# Autodesk Inventor assembly: BuckConverter_10A_Assembly
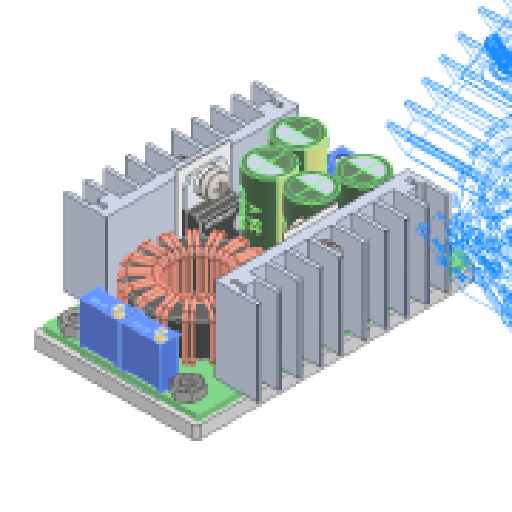
[picture p0: Inventor's stored thumbnail of the model, 512x512]
Saved by Autodesk Inventor 2025 (Build 290162000, 162)
## iProperties
Created: 2024-11-14
Part Number: BuckConverter_10A_Assembly
Document SubType Name: Assembly
Designer: OSB
Mass: 55.5 g
Surface Area: 335.586 cm^2
Volume: 25.8224 cm^3
Sending System: Autodesk Inventor 2021
Preprocessor: unknown
Minimum Resolution: 0.01
Sent Units: Millimeter
Translation Standard: IGES 5.3
Model Creation Time: 2020-07-07
Title: S500 Frame
Author: OSB
## Documents named in this file (4)
- C:\Users\OSB\Desktop\SB\1.Projects\캡스톤 디자인(2)_Paper\Modeling\Implementation_Design\Ver_004_mass_update\BuckConverter_10A_Assembly.iam
- C:\Users\OSB\Desktop\SB\1.Projects\캡스톤 디자인(2)_Paper\Modeling\Implementation_Design\Ver_004_mass_update\BuckConverter_10A_Module.ipt
- C:\Users\OSB\Desktop\SB\1.Projects\캡스톤 디자인(2)_Paper\Modeling\Implementation_Design\Ver_004_mass_update\BuckConverter_10A_Spacer.ipt
- C:\Users\OSB\Documents\Inventor\Content Center Files\R2025\ko-KR\KS B 1012  S2 F\KS B 1012 - M 3(1).ipt
## Components (6 placed, 3 different names)
1. BuckConverter_10A_Module:1 — 회전:1, 메이트:1, 삽입:1, 삽입:2, 삽입:3, 삽입:4
2. BuckConverter_10A_Spacer:1 — 회전:1, 메이트:1
3. KS B 1012 스타일 2 다듬질 - 미터 M 3:1 — 삽입:1
4. KS B 1012 스타일 2 다듬질 - 미터 M 3:2 — 삽입:2
5. KS B 1012 스타일 2 다듬질 - 미터 M 3:3 — 삽입:3
6. KS B 1012 스타일 2 다듬질 - 미터 M 3:4 — 삽입:4
## Relationships (6: Insert 4, RevoluteJoint 1, Mate 1)
- 회전:1 [RevoluteJoint]: BuckConverter_10A_Module:1 ↔ BuckConverter_10A_Spacer:1
- 메이트:1 [Mate]: BuckConverter_10A_Module:1 ↔ BuckConverter_10A_Spacer:1
- 삽입:1 [Insert]: BuckConverter_10A_Module:1 ↔ KS B 1012 스타일 2 다듬질 - 미터 M 3:1
- 삽입:2 [Insert]: BuckConverter_10A_Module:1 ↔ KS B 1012 스타일 2 다듬질 - 미터 M 3:2
- 삽입:3 [Insert]: BuckConverter_10A_Module:1 ↔ KS B 1012 스타일 2 다듬질 - 미터 M 3:3
- 삽입:4 [Insert]: BuckConverter_10A_Module:1 ↔ KS B 1012 스타일 2 다듬질 - 미터 M 3:4
